# Autodesk Inventor assembly: dau_robot
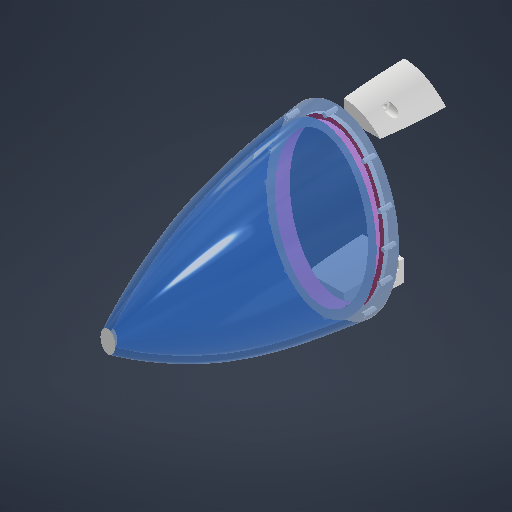
[picture p0: Inventor's stored thumbnail of the model, 512x512]
Saved by Autodesk Inventor 2027 (Build 310192060, 192F)
## iProperties
Created: 2026-08-27
Part Number: dau_robot
Document SubType Name: Assembly
Designer: DELL
Author: DELL
## Documents named in this file (6)
- D:\Downloads\robot_fishv12_\Workgroups\NotInProject\dau_robot.iam
- D:\Downloads\robot_fishv12_\Workgroups\NotInProject\head.ipt
- D:\Downloads\robot_fishv12_\Workgroups\NotInProject\nap_dau_ca.ipt
- D:\Downloads\robot_fishv12_\Workgroups\NotInProject\solid_in_head.ipt
- D:\Downloads\robot_fishv12_\Workgroups\NotInProject\manh_nap_tren.ipt
- D:\Downloads\robot_fishv12_\Workgroups\NotInProject\manh_nap_duoi.ipt
## Components (5 placed, 5 different names)
1. head:1 — Rigid:1
2. nap_dau_ca:1 — Mate:1, Rigid:1, Rigid:2, Rigid:3, Mate:2
3. solid_in_head:1 — Mate:1
4. manh_nap_tren:1 — Rigid:2, Angle:1
5. manh_nap_duoi:1 — Rigid:3
## Relationships (8: WeldJoint 3, Mate 2, Flush 2, Angle 1)
- Mate:1: nap_dau_ca:1 ↔ solid_in_head:1
- Rigid:1 [WeldJoint]: head:1 ↔ nap_dau_ca:1
- Rigid:2 [WeldJoint]: nap_dau_ca:1 ↔ manh_nap_tren:1
- Rigid:3 [WeldJoint]: nap_dau_ca:1 ↔ manh_nap_duoi:1
- Mate:2: nap_dau_ca:1
- Angle:1 (90 deg): manh_nap_tren:1
- Flush:1 (30 mm)
- Flush:2 (-30 mm)
